# Autodesk Inventor assembly: Ensamblaje1
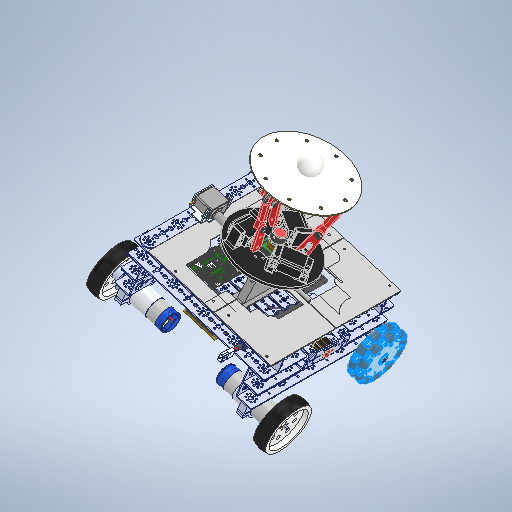
[picture p0: Inventor's stored thumbnail of the model, 512x512]
Saved by Autodesk Inventor 2025.4 (Build 294407000, 407)
## iProperties
Created: 2026-09-20
Part Number: Ensamblaje1
Document SubType Name: Assembly
Designer: usuario
Mass: 1778.88 g
Surface Area: 10785.4 cm^2
Volume: 1778.88 cm^3
Density: 1 g/cm^3
Author: usuario
## Documents named in this file (36)
- D:\Utec\Ciclo10\DSM\DSM_CAD_REPARADO\Ensamblaje1.iam
- D:\Utec\Ciclo10\DSM\DSM_CAD_REPARADO\Dependencias\EXT_003\Tetrix 4 inch Dual Omni Wheel(2).ipt
- D:\Utec\Ciclo10\DSM\DSM_CAD_REPARADO\Dependencias\EXT_003\Tetrix 4 inch Wheel.ipt
- D:\Utec\Ciclo10\DSM\DSM_CAD_REPARADO\Dependencias\EXT_003\Tetrix 32mm Channel.ipt
- D:\Utec\Ciclo10\DSM\DSM_CAD_REPARADO\Dependencias\EXT_003\Tetrix 96mm Channel.ipt
- D:\Utec\Ciclo10\DSM\DSM_CAD_REPARADO\Dependencias\EXT_003\Tetrix Motor Mount.ipt
- D:\Utec\Ciclo10\DSM\DSM_CAD_REPARADO\Dependencias\EXT_003\Tetrix TorqueNADO DC Motor(2).ipt
- D:\Utec\Ciclo10\DSM\DSM_CAD_REPARADO\Dependencias\EXT_003\Tetrix Flat Building Plate.ipt
- D:\Utec\Ciclo10\DSM\DSM_CAD_REPARADO\Dependencias\EXT_003\Tetrix 416mm Channel.ipt
- D:\Utec\Ciclo10\DSM\DSM_CAD_REPARADO\Dependencias\EXT_003\Tetrix Gear Hub Spacer.ipt
- D:\Utec\Ciclo10\DSM\DSM_CAD_REPARADO\Dependencias\EXT_003\Tetrix Flat 288mmx26mm.ipt
- D:\Utec\Ciclo10\DSM\DSM_CAD_REPARADO\Dependencias\EXT_003\Tetrix Battery Plate(2).ipt
- D:\Utec\Ciclo10\DSM\DSM_CAD_REPARADO\Dependencias\EXT_003\Motor Driver.ipt
- D:\Utec\Ciclo10\DSM\DSM_CAD_REPARADO\Dependencias\EXT_003\39057_txm-12v 3000mah battery pack assembly.ipt
- D:\Utec\Ciclo10\DSM\DSM_CAD_REPARADO\Dependencias\EXT_003\myRIO-1900-MJG_v1.ipt
- D:\Utec\Ciclo10\DSM\DSM_CAD_REPARADO\Dependencias\EXT_003\Raspberry Pi 4 Model B.ipt
- D:\Utec\Ciclo10\DSM\DSM_CAD_REPARADO\Dependencias\EXT_003\Tetrix Flat 160mm x26mm.ipt
- D:\Utec\Ciclo10\DSM\DSM_CAD_REPARADO\Dependencias\EXT_003\Tetrix StandOff Post 6-32x28mm.ipt
- D:\Utec\Ciclo10\DSM\DSM_CAD_REPARADO\Piezas\Base_inclinacion.ipt
- D:\Utec\Ciclo10\DSM\DSM_CAD_REPARADO\Piezas\adaptador_eje.ipt
- D:\Utec\Ciclo10\DSM\DSM_CAD_REPARADO\Piezas\Tetrix 6mm x 100mm Axle(2).ipt
- D:\Utec\Ciclo10\DSM\DSM_CAD_REPARADO\Piezas\Tetrix 485HB Standard Servo with Horn(2).ipt
- D:\Utec\Ciclo10\DSM\DSM_CAD_REPARADO\Piezas\Tetrix Axle Hub With Set Screw(2).ipt
- D:\Utec\Ciclo10\DSM\DSM_CAD_REPARADO\Piezas\Tetrix 96mm Channel(2).ipt
- D:\Utec\Ciclo10\DSM\DSM_CAD_REPARADO\Dependencias\EXT_002\ENSAMBLE_BALL_DSM.iam
- D:\Utec\Ciclo10\DSM\DSM_CAD_REPARADO\Piezas\39060_txm-standard servo bracket.ipt
- D:\Utec\Ciclo10\DSM\DSM_CAD_REPARADO\Piezas\Tetrix Flat 96mmx26mm.ipt
- D:\Utec\Ciclo10\DSM\DSM_CAD_REPARADO\Piezas\Tetrix L Bracket.ipt
- D:\Utec\Ciclo10\DSM\DSM_CAD_REPARADO\Piezas\39176_tetrixswitchmount.ipt
- D:\Utec\Ciclo10\DSM\DSM_CAD_REPARADO\Piezas\Apagador 2024.ipt
- D:\Utec\Ciclo10\DSM\DSM_CAD_REPARADO\Piezas\robot_v13.iam
- D:\Utec\Ciclo10\DSM\DSM_CAD_REPARADO\Piezas\CN6009.iam
- D:\Utec\Ciclo10\DSM\DSM_CAD_REPARADO\Piezas\Tetrix Bronze Bushing 6mm.ipt
- D:\Utec\Ciclo10\DSM\DSM_CAD_REPARADO\Piezas\Tetrix Axle Spacer 0.125.ipt
- D:\Utec\Ciclo10\DSM\DSM_CAD_REPARADO\Dependencias\EXT_001\40225_txp-6mm x 80mm axle.ipt
- D:\Utec\Ciclo10\DSM\DSM_CAD_REPARADO\Piezas\Tapa_2 - copia.ipt
## Components (64 placed, 35 different names)
1. Tetrix 4 inch Dual Omni Wheel(2):1 — Coincidencia:93, Coincidencia:270, Coincidencia:271, Coincidencia:277, Coincidencia:279
2. Tetrix 4 inch Dual Omni Wheel(2):2 — Coincidencia:262, Coincidencia:263, Coincidencia:268
3. Tetrix 4 inch Wheel:1 — Coincidencia:31, Coincidencia:32, Coincidencia:33, Coincidencia:35
4. Tetrix 4 inch Wheel:2 — Coincidencia:1, Coincidencia:2, Coincidencia:11
5. Tetrix 32mm Channel:2 — Coincidencia:12, Coincidencia:13, Coincidencia:93, Coincidencia:272, Coincidencia:273, Coincidencia:274, Coincidencia:275, Coincidencia:277, Coincidencia:283
6. Tetrix 32mm Channel:3 — Coincidencia:36, Coincidencia:37, Coincidencia:256, Coincidencia:257, Coincidencia:258, Coincidencia:259, Coincidencia:262, Coincidencia:281
7. Tetrix 96mm Channel:3 — Coincidencia:46, Coincidencia:47, Coincidencia:48
8. Tetrix Motor Mount:1 — Coincidencia:7, Coincidencia:8, Coincidencia:9, Coincidencia:10, Coincidencia:11
9. Tetrix Motor Mount:2 — Coincidencia:27, Coincidencia:28, Coincidencia:29, Coincidencia:30, Coincidencia:35
10. Tetrix TorqueNADO DC Motor(2):1 — Coincidencia:3, Coincidencia:4, Coincidencia:10
11. Tetrix TorqueNADO DC Motor(2):2 — Coincidencia:30, Coincidencia:31, Coincidencia:34
12. Tetrix Flat Building Plate:1 — Coincidencia:89, Coincidencia:90, Coincidencia:91, Coincidencia:142, Coincidencia:215, Coincidencia:216, Coincidencia:217, Coincidencia:240, Coincidencia:241, Coincidencia:242
13. Tetrix Flat Building Plate:2 — Coincidencia:86, Coincidencia:87, Coincidencia:88, Coincidencia:196, Coincidencia:218, Coincidencia:219, Coincidencia:220, Coincidencia:236, Coincidencia:237, Coincidencia:238, Coincidencia:239, Coincidencia:246, Coincidencia:247, Coincidencia:248, Coincidencia:249, Coincidencia:250, Coincidencia:251, Coincidencia:252
14. Tetrix 416mm Channel:1 — Coincidencia:7, Coincidencia:8, Coincidencia:9, Coincidencia:12, Coincidencia:13, Coincidencia:46, Coincidencia:47, Coincidencia:48, Coincidencia:55, Coincidencia:56, Coincidencia:57, Coincidencia:78, Coincidencia:79, Coincidencia:80, Coincidencia:84, Coincidencia:85
15. Tetrix Gear Hub Spacer:2 — Coincidencia:1, Coincidencia:2, Coincidencia:3, Coincidencia:4
16. Tetrix Gear Hub Spacer:4 — Coincidencia:32, Coincidencia:33, Coincidencia:34
17. Tetrix 416mm Channel:2 — Coincidencia:27, Coincidencia:28, Coincidencia:29, Coincidencia:36, Coincidencia:37, Coincidencia:49, Coincidencia:50, Coincidencia:51, Coincidencia:52, Coincidencia:53, Coincidencia:54, Coincidencia:77, Coincidencia:81, Coincidencia:82, Coincidencia:83, Coincidencia:226, Coincidencia:227
18. Tetrix 416mm Channel:3 — Coincidencia:168, Coincidencia:169, Coincidencia:170, Coincidencia:172, Coincidencia:209, Coincidencia:294, Coincidencia:295
19. Tetrix 96mm Channel:4 — Coincidencia:49, Coincidencia:50, Coincidencia:51, Coincidencia:105, Coincidencia:107, Coincidencia:168, Coincidencia:169, Coincidencia:170
20. Tetrix 96mm Channel:5 — Coincidencia:52, Coincidencia:53, Coincidencia:54, Coincidencia:91
21. Tetrix 96mm Channel:6 — Coincidencia:55, Coincidencia:56, Coincidencia:57, Coincidencia:88, Coincidencia:165, Coincidencia:166, Coincidencia:167
22. Tetrix 416mm Channel:4 — Coincidencia:165, Coincidencia:166, Coincidencia:167, Coincidencia:171, Coincidencia:173
23. Tetrix Flat 288mmx26mm:1 — Coincidencia:83, Coincidencia:84, Coincidencia:85, Coincidencia:116, Coincidencia:117, Coincidencia:118, Coincidencia:119, Coincidencia:162
24. Tetrix Flat 288mmx26mm:2 — Coincidencia:80, Coincidencia:81, Coincidencia:82, Coincidencia:86, Coincidencia:89, Coincidencia:163, Coincidencia:223, Coincidencia:224, Coincidencia:225
25. Tetrix Flat 288mmx26mm:3 — Coincidencia:77, Coincidencia:78, Coincidencia:79, Coincidencia:87, Coincidencia:90, Coincidencia:197, Coincidencia:228, Coincidencia:229, Coincidencia:245
26. Tetrix Battery Plate(2):2 — Coincidencia:105, Coincidencia:107, Coincidencia:149, Coincidencia:209
27. Motor Driver:1 — Coincidencia:221, Coincidencia:222, Coincidencia:236
28. 39057_txm-12v 3000mah battery pack assembly:1 — Coincidencia:142, Coincidencia:149
29. myRIO-1900-MJG_v1:1 — Coincidencia:162, Coincidencia:163, Coincidencia:164
30. Raspberry Pi 4 Model B:1 — Coincidencia:247, Coincidencia:248, Coincidencia:249
31. Tetrix Flat 160mm x26mm:2 — Coincidencia:120, Coincidencia:121, Coincidencia:122
32. Tetrix StandOff Post 6-32x28mm:1 — Coincidencia:116, Coincidencia:117, Coincidencia:122
33. Tetrix StandOff Post 6-32x28mm:3 — Coincidencia:118, Coincidencia:119, Coincidencia:120, Coincidencia:121, Coincidencia:164
34. Tetrix Flat 288mmx26mm:4 — Coincidencia:171, Coincidencia:172, Coincidencia:173, Coincidencia:200, Coincidencia:201, Coincidencia:253
35. Base_inclinacion:1 — Coincidencia:175, Coincidencia:176, Coincidencia:177, Coincidencia:178, Coincidencia:196, Coincidencia:197, Coincidencia:223
36. adaptador_eje:1 — Coincidencia:185, Coincidencia:186, Coincidencia:198
37. Tetrix 6mm x 100mm Axle(2):1 — Coincidencia:198, Coincidencia:199
38. Tetrix 485HB Standard Servo with Horn(2):1 — Coincidencia:185, Coincidencia:186, Coincidencia:188, Coincidencia:189, Coincidencia:190, Coincidencia:199
39. Tetrix Axle Hub With Set Screw(2):1 — Coincidencia:177, Coincidencia:178
40. Tetrix Axle Hub With Set Screw(2):2 — Coincidencia:175, Coincidencia:176, Coincidencia:194, Coincidencia:195
41. Tetrix 96mm Channel(2):1 — Coincidencia:194, Coincidencia:195, Coincidencia:290, Coincidencia:291, Coincidencia:292, Coincidencia:293
42. ENSAMBLE_BALL_DSM:1 [sub-assembly] — Coincidencia:290, Coincidencia:291, Coincidencia:292, Coincidencia:293
43. 39060_txm-standard servo bracket:1 — Coincidencia:188, Coincidencia:189, Coincidencia:190, Coincidencia:200, Coincidencia:201, Coincidencia:253
44. Tetrix Flat 96mmx26mm:3 — Coincidencia:215, Coincidencia:216, Coincidencia:217, Coincidencia:221, Coincidencia:222
45. Tetrix Flat 96mmx26mm:4 — Coincidencia:218, Coincidencia:219, Coincidencia:220
46. Tetrix L Bracket:1 — Coincidencia:224, Coincidencia:225, Coincidencia:226, Coincidencia:234, Coincidencia:235
47. Tetrix L Bracket:2 — Coincidencia:227, Coincidencia:228, Coincidencia:229, Coincidencia:233
48. 39176_tetrixswitchmount:1 — Coincidencia:230, Coincidencia:231, Coincidencia:232, Coincidencia:233, Coincidencia:234, Coincidencia:235
49. Apagador 2024:1 — Coincidencia:230, Coincidencia:231, Coincidencia:232
50. robot_v13:1 [sub-assembly] — Coincidencia:244, Coincidencia:245, Coincidencia:246
51. Tetrix Flat 96mmx26mm:5 — Coincidencia:237, Coincidencia:238, Coincidencia:239, Coincidencia:244
52. Tetrix Flat 96mmx26mm:6 — Coincidencia:240, Coincidencia:241, Coincidencia:242
53. CN6009:1 [sub-assembly] — Coincidencia:250, Coincidencia:251, Coincidencia:252
54. Tetrix Bronze Bushing 6mm:4 — Coincidencia:256, Coincidencia:257, Coincidencia:269
55. Tetrix Bronze Bushing 6mm:5 — Coincidencia:258, Coincidencia:259
56. Tetrix Axle Spacer 0.125:1 — Coincidencia:263, Coincidencia:266, Coincidencia:267
57. 40225_txp-6mm x 80mm axle:1 — Coincidencia:266, Coincidencia:267, Coincidencia:268, Coincidencia:269, Coincidencia:280
58. 40225_txp-6mm x 80mm axle:2 — Coincidencia:270, Coincidencia:271, Coincidencia:276, Coincidencia:278, Coincidencia:282
59. Tetrix Bronze Bushing 6mm:6 — Coincidencia:272, Coincidencia:273, Coincidencia:276
60. Tetrix Bronze Bushing 6mm:7 — Coincidencia:274, Coincidencia:275
61. Tetrix Axle Spacer 0.125:3 — Coincidencia:278, Coincidencia:279
62. Tetrix Axle Spacer 0.125:4 — Coincidencia:280, Coincidencia:281
63. Tetrix Axle Spacer 0.125:5 — Coincidencia:282, Coincidencia:283
64. Tapa_2 - copia:1 — Coincidencia:294, Coincidencia:295
## Relationships (159: Mate 159)
- Coincidencia:1 [Mate]: Tetrix 4 inch Wheel:2 ↔ Tetrix Gear Hub Spacer:2
- Coincidencia:2 [Mate]: Tetrix 4 inch Wheel:2 ↔ Tetrix Gear Hub Spacer:2
- Coincidencia:3 [Mate]: Tetrix TorqueNADO DC Motor(2):1 ↔ Tetrix Gear Hub Spacer:2
- Coincidencia:4 [Mate]: Tetrix TorqueNADO DC Motor(2):1 ↔ Tetrix Gear Hub Spacer:2
- Coincidencia:7 [Mate]: Tetrix Motor Mount:1 ↔ Tetrix 416mm Channel:1
- Coincidencia:8 [Mate]: Tetrix Motor Mount:1 ↔ Tetrix 416mm Channel:1
- Coincidencia:9 [Mate]: Tetrix Motor Mount:1 ↔ Tetrix 416mm Channel:1
- Coincidencia:10 [Mate]: Tetrix Motor Mount:1 ↔ Tetrix TorqueNADO DC Motor(2):1
- Coincidencia:11 [Mate] (35 mm): Tetrix 4 inch Wheel:2 ↔ Tetrix Motor Mount:1
- Coincidencia:12 [Mate]: Tetrix 32mm Channel:2 ↔ Tetrix 416mm Channel:1
- Coincidencia:13 [Mate]: Tetrix 32mm Channel:2 ↔ Tetrix 416mm Channel:1
- Coincidencia:27 [Mate]: Tetrix Motor Mount:2 ↔ Tetrix 416mm Channel:2
- Coincidencia:28 [Mate]: Tetrix Motor Mount:2 ↔ Tetrix 416mm Channel:2
- Coincidencia:29 [Mate]: Tetrix Motor Mount:2 ↔ Tetrix 416mm Channel:2
- Coincidencia:30 [Mate]: Tetrix Motor Mount:2 ↔ Tetrix TorqueNADO DC Motor(2):2
- Coincidencia:31 [Mate]: Tetrix 4 inch Wheel:1 ↔ Tetrix TorqueNADO DC Motor(2):2
- Coincidencia:32 [Mate]: Tetrix 4 inch Wheel:1 ↔ Tetrix Gear Hub Spacer:4
- Coincidencia:33 [Mate]: Tetrix 4 inch Wheel:1 ↔ Tetrix Gear Hub Spacer:4
- Coincidencia:34 [Mate]: Tetrix TorqueNADO DC Motor(2):2 ↔ Tetrix Gear Hub Spacer:4
- Coincidencia:35 [Mate] (35 mm): Tetrix 4 inch Wheel:1 ↔ Tetrix Motor Mount:2
- Coincidencia:36 [Mate]: Tetrix 32mm Channel:3 ↔ Tetrix 416mm Channel:2
- Coincidencia:37 [Mate]: Tetrix 32mm Channel:3 ↔ Tetrix 416mm Channel:2
- Coincidencia:46 [Mate]: Tetrix 96mm Channel:3 ↔ Tetrix 416mm Channel:1
- Coincidencia:47 [Mate]: Tetrix 96mm Channel:3 ↔ Tetrix 416mm Channel:1
- Coincidencia:48 [Mate]: Tetrix 96mm Channel:3 ↔ Tetrix 416mm Channel:1
- Coincidencia:49 [Mate]: Tetrix 416mm Channel:2 ↔ Tetrix 96mm Channel:4
- Coincidencia:50 [Mate]: Tetrix 416mm Channel:2 ↔ Tetrix 96mm Channel:4
- Coincidencia:51 [Mate]: Tetrix 416mm Channel:2 ↔ Tetrix 96mm Channel:4
- Coincidencia:52 [Mate]: Tetrix 416mm Channel:2 ↔ Tetrix 96mm Channel:5
- Coincidencia:53 [Mate]: Tetrix 416mm Channel:2 ↔ Tetrix 96mm Channel:5
- Coincidencia:54 [Mate]: Tetrix 416mm Channel:2 ↔ Tetrix 96mm Channel:5
- Coincidencia:55 [Mate]: Tetrix 416mm Channel:1 ↔ Tetrix 96mm Channel:6
- Coincidencia:56 [Mate]: Tetrix 416mm Channel:1 ↔ Tetrix 96mm Channel:6
- Coincidencia:57 [Mate]: Tetrix 416mm Channel:1 ↔ Tetrix 96mm Channel:6
- Coincidencia:77 [Mate]: Tetrix 416mm Channel:2 ↔ Tetrix Flat 288mmx26mm:3
- Coincidencia:78 [Mate]: Tetrix 416mm Channel:1 ↔ Tetrix Flat 288mmx26mm:3
- Coincidencia:79 [Mate]: Tetrix 416mm Channel:1 ↔ Tetrix Flat 288mmx26mm:3
- Coincidencia:80 [Mate]: Tetrix 416mm Channel:1 ↔ Tetrix Flat 288mmx26mm:2
- Coincidencia:81 [Mate]: Tetrix 416mm Channel:2 ↔ Tetrix Flat 288mmx26mm:2
- Coincidencia:82 [Mate]: Tetrix 416mm Channel:2 ↔ Tetrix Flat 288mmx26mm:2
- Coincidencia:83 [Mate]: Tetrix 416mm Channel:2 ↔ Tetrix Flat 288mmx26mm:1
- Coincidencia:84 [Mate]: Tetrix 416mm Channel:1 ↔ Tetrix Flat 288mmx26mm:1
- Coincidencia:85 [Mate]: Tetrix 416mm Channel:1 ↔ Tetrix Flat 288mmx26mm:1
- Coincidencia:86 [Mate]: Tetrix Flat Building Plate:2 ↔ Tetrix Flat 288mmx26mm:2
- Coincidencia:87 [Mate]: Tetrix Flat Building Plate:2 ↔ Tetrix Flat 288mmx26mm:3
- Coincidencia:88 [Mate]: Tetrix Flat Building Plate:2 ↔ Tetrix 96mm Channel:6
- Coincidencia:89 [Mate]: Tetrix Flat Building Plate:1 ↔ Tetrix Flat 288mmx26mm:2
- Coincidencia:90 [Mate]: Tetrix Flat Building Plate:1 ↔ Tetrix Flat 288mmx26mm:3
- Coincidencia:91 [Mate]: Tetrix Flat Building Plate:1 ↔ Tetrix 96mm Channel:5
- Coincidencia:93 [Mate]: Tetrix 4 inch Dual Omni Wheel(2):1 ↔ Tetrix 32mm Channel:2
- Coincidencia:105 [Mate]: Tetrix 96mm Channel:4 ↔ Tetrix Battery Plate(2):2
- Coincidencia:107 [Mate]: Tetrix 96mm Channel:4 ↔ Tetrix Battery Plate(2):2
- Coincidencia:116 [Mate]: Tetrix Flat 288mmx26mm:1 ↔ Tetrix StandOff Post 6-32x28mm:1
- Coincidencia:117 [Mate]: Tetrix Flat 288mmx26mm:1 ↔ Tetrix StandOff Post 6-32x28mm:1
- Coincidencia:118 [Mate]: Tetrix Flat 288mmx26mm:1 ↔ Tetrix StandOff Post 6-32x28mm:3
- Coincidencia:119 [Mate]: Tetrix Flat 288mmx26mm:1 ↔ Tetrix StandOff Post 6-32x28mm:3
- Coincidencia:120 [Mate]: Tetrix Flat 160mm x26mm:2 ↔ Tetrix StandOff Post 6-32x28mm:3
- Coincidencia:121 [Mate]: Tetrix Flat 160mm x26mm:2 ↔ Tetrix StandOff Post 6-32x28mm:3
- Coincidencia:122 [Mate]: Tetrix Flat 160mm x26mm:2 ↔ Tetrix StandOff Post 6-32x28mm:1
- Coincidencia:142 [Mate]: Tetrix Flat Building Plate:1 ↔ 39057_txm-12v 3000mah battery pack assembly:1
- Coincidencia:149 [Mate]: Tetrix Battery Plate(2):2 ↔ 39057_txm-12v 3000mah battery pack assembly:1
- Coincidencia:162 [Mate]: Tetrix Flat 288mmx26mm:1 ↔ myRIO-1900-MJG_v1:1
- Coincidencia:163 [Mate]: Tetrix Flat 288mmx26mm:2 ↔ myRIO-1900-MJG_v1:1
- Coincidencia:164 [Mate]: myRIO-1900-MJG_v1:1 ↔ Tetrix StandOff Post 6-32x28mm:3
- Coincidencia:165 [Mate]: Tetrix 96mm Channel:6 ↔ Tetrix 416mm Channel:4
- Coincidencia:166 [Mate]: Tetrix 96mm Channel:6 ↔ Tetrix 416mm Channel:4
- Coincidencia:167 [Mate]: Tetrix 96mm Channel:6 ↔ Tetrix 416mm Channel:4
- Coincidencia:168 [Mate]: Tetrix 416mm Channel:3 ↔ Tetrix 96mm Channel:4
- Coincidencia:169 [Mate]: Tetrix 416mm Channel:3 ↔ Tetrix 96mm Channel:4
- Coincidencia:170 [Mate]: Tetrix 416mm Channel:3 ↔ Tetrix 96mm Channel:4
- Coincidencia:171 [Mate]: Tetrix 416mm Channel:4 ↔ Tetrix Flat 288mmx26mm:4
- Coincidencia:172 [Mate]: Tetrix 416mm Channel:3 ↔ Tetrix Flat 288mmx26mm:4
- Coincidencia:173 [Mate]: Tetrix 416mm Channel:4 ↔ Tetrix Flat 288mmx26mm:4
- Coincidencia:175 [Mate]: Base_inclinacion:1 ↔ Tetrix Axle Hub With Set Screw(2):2
- Coincidencia:176 [Mate]: Base_inclinacion:1 ↔ Tetrix Axle Hub With Set Screw(2):2
- Coincidencia:177 [Mate]: Base_inclinacion:1 ↔ Tetrix Axle Hub With Set Screw(2):1
- Coincidencia:178 [Mate]: Base_inclinacion:1 ↔ Tetrix Axle Hub With Set Screw(2):1
- Coincidencia:185 [Mate]: adaptador_eje:1 ↔ Tetrix 485HB Standard Servo with Horn(2):1
- Coincidencia:186 [Mate]: adaptador_eje:1 ↔ Tetrix 485HB Standard Servo with Horn(2):1
- Coincidencia:188 [Mate]: Tetrix 485HB Standard Servo with Horn(2):1 ↔ 39060_txm-standard servo bracket:1
- Coincidencia:189 [Mate]: Tetrix 485HB Standard Servo with Horn(2):1 ↔ 39060_txm-standard servo bracket:1
- Coincidencia:190 [Mate]: Tetrix 485HB Standard Servo with Horn(2):1 ↔ 39060_txm-standard servo bracket:1
- Coincidencia:194 [Mate]: Tetrix Axle Hub With Set Screw(2):2 ↔ Tetrix 96mm Channel(2):1
- Coincidencia:195 [Mate]: Tetrix Axle Hub With Set Screw(2):2 ↔ Tetrix 96mm Channel(2):1
- Coincidencia:196 [Mate] (34 mm): Tetrix Flat Building Plate:2 ↔ Base_inclinacion:1
- Coincidencia:197 [Mate]: Tetrix Flat 288mmx26mm:3 ↔ Base_inclinacion:1
- Coincidencia:198 [Mate]: adaptador_eje:1 ↔ Tetrix 6mm x 100mm Axle(2):1
- Coincidencia:199 [Mate]: Tetrix 6mm x 100mm Axle(2):1 ↔ Tetrix 485HB Standard Servo with Horn(2):1
- Coincidencia:200 [Mate]: Tetrix Flat 288mmx26mm:4 ↔ 39060_txm-standard servo bracket:1
- Coincidencia:201 [Mate]: Tetrix Flat 288mmx26mm:4 ↔ 39060_txm-standard servo bracket:1
- Coincidencia:209 [Mate]: Tetrix 416mm Channel:3 ↔ Tetrix Battery Plate(2):2
- Coincidencia:215 [Mate]: Tetrix Flat Building Plate:1 ↔ Tetrix Flat 96mmx26mm:3
- Coincidencia:216 [Mate]: Tetrix Flat Building Plate:1 ↔ Tetrix Flat 96mmx26mm:3
- Coincidencia:217 [Mate]: Tetrix Flat Building Plate:1 ↔ Tetrix Flat 96mmx26mm:3
- Coincidencia:218 [Mate]: Tetrix Flat Building Plate:2 ↔ Tetrix Flat 96mmx26mm:4
- Coincidencia:219 [Mate]: Tetrix Flat Building Plate:2 ↔ Tetrix Flat 96mmx26mm:4
- Coincidencia:220 [Mate]: Tetrix Flat Building Plate:2 ↔ Tetrix Flat 96mmx26mm:4
- Coincidencia:221 [Mate]: Motor Driver:1 ↔ Tetrix Flat 96mmx26mm:3
- Coincidencia:222 [Mate] (6 mm): Motor Driver:1 ↔ Tetrix Flat 96mmx26mm:3
- Coincidencia:223 [Mate]: Tetrix Flat 288mmx26mm:2 ↔ Base_inclinacion:1
- Coincidencia:224 [Mate]: Tetrix Flat 288mmx26mm:2 ↔ Tetrix L Bracket:1
- Coincidencia:225 [Mate]: Tetrix Flat 288mmx26mm:2 ↔ Tetrix L Bracket:1
- Coincidencia:226 [Mate]: Tetrix 416mm Channel:2 ↔ Tetrix L Bracket:1
- Coincidencia:227 [Mate]: Tetrix 416mm Channel:2 ↔ Tetrix L Bracket:2
- Coincidencia:228 [Mate]: Tetrix Flat 288mmx26mm:3 ↔ Tetrix L Bracket:2
- Coincidencia:229 [Mate]: Tetrix Flat 288mmx26mm:3 ↔ Tetrix L Bracket:2
- Coincidencia:230 [Mate]: 39176_tetrixswitchmount:1 ↔ Apagador 2024:1
- Coincidencia:231 [Mate] (2.8 mm): 39176_tetrixswitchmount:1 ↔ Apagador 2024:1
- Coincidencia:232 [Mate] (1.2 mm): 39176_tetrixswitchmount:1 ↔ Apagador 2024:1
- Coincidencia:233 [Mate]: Tetrix L Bracket:2 ↔ 39176_tetrixswitchmount:1
- Coincidencia:234 [Mate]: Tetrix L Bracket:1 ↔ 39176_tetrixswitchmount:1
- Coincidencia:235 [Mate]: Tetrix L Bracket:1 ↔ 39176_tetrixswitchmount:1
- Coincidencia:236 [Mate] (6 mm): Tetrix Flat Building Plate:2 ↔ Motor Driver:1
- Coincidencia:237 [Mate]: Tetrix Flat Building Plate:2 ↔ Tetrix Flat 96mmx26mm:5
- Coincidencia:238 [Mate]: Tetrix Flat Building Plate:2 ↔ Tetrix Flat 96mmx26mm:5
- Coincidencia:239 [Mate]: Tetrix Flat Building Plate:2 ↔ Tetrix Flat 96mmx26mm:5
- Coincidencia:240 [Mate]: Tetrix Flat Building Plate:1 ↔ Tetrix Flat 96mmx26mm:6
- Coincidencia:241 [Mate]: Tetrix Flat Building Plate:1 ↔ Tetrix Flat 96mmx26mm:6
- Coincidencia:242 [Mate]: Tetrix Flat Building Plate:1 ↔ Tetrix Flat 96mmx26mm:6
- Coincidencia:244 [Mate]: robot_v13:1 ↔ Tetrix Flat 96mmx26mm:5
- Coincidencia:245 [Mate] (20 mm): Tetrix Flat 288mmx26mm:3 ↔ robot_v13:1
- Coincidencia:246 [Mate] (15 mm): Tetrix Flat Building Plate:2 ↔ robot_v13:1
- Coincidencia:247 [Mate]: Tetrix Flat Building Plate:2 ↔ Raspberry Pi 4 Model B:1
- Coincidencia:248 [Mate] (10 mm): Tetrix Flat Building Plate:2 ↔ Raspberry Pi 4 Model B:1
- Coincidencia:249 [Mate] (60 mm): Tetrix Flat Building Plate:2 ↔ Raspberry Pi 4 Model B:1
- Coincidencia:250 [Mate]: Tetrix Flat Building Plate:2 ↔ CN6009:1
- Coincidencia:251 [Mate] (15 mm): Tetrix Flat Building Plate:2 ↔ CN6009:1
- Coincidencia:252 [Mate] (12 mm): Tetrix Flat Building Plate:2 ↔ CN6009:1
- Coincidencia:253 [Mate]: Tetrix Flat 288mmx26mm:4 ↔ 39060_txm-standard servo bracket:1
- Coincidencia:256 [Mate]: Tetrix 32mm Channel:3 ↔ Tetrix Bronze Bushing 6mm:4
- Coincidencia:257 [Mate]: Tetrix 32mm Channel:3 ↔ Tetrix Bronze Bushing 6mm:4
- Coincidencia:258 [Mate]: Tetrix 32mm Channel:3 ↔ Tetrix Bronze Bushing 6mm:5
- Coincidencia:259 [Mate]: Tetrix 32mm Channel:3 ↔ Tetrix Bronze Bushing 6mm:5
- Coincidencia:262 [Mate]: Tetrix 4 inch Dual Omni Wheel(2):2 ↔ Tetrix 32mm Channel:3
- Coincidencia:263 [Mate]: Tetrix 4 inch Dual Omni Wheel(2):2 ↔ Tetrix Axle Spacer 0.125:1
- Coincidencia:266 [Mate]: Tetrix Axle Spacer 0.125:1 ↔ 40225_txp-6mm x 80mm axle:1
- Coincidencia:267 [Mate]: Tetrix Axle Spacer 0.125:1 ↔ 40225_txp-6mm x 80mm axle:1
- Coincidencia:268 [Mate]: Tetrix 4 inch Dual Omni Wheel(2):2 ↔ 40225_txp-6mm x 80mm axle:1
- Coincidencia:269 [Mate]: Tetrix Bronze Bushing 6mm:4 ↔ 40225_txp-6mm x 80mm axle:1
- Coincidencia:270 [Mate]: Tetrix 4 inch Dual Omni Wheel(2):1 ↔ 40225_txp-6mm x 80mm axle:2
- Coincidencia:271 [Mate]: Tetrix 4 inch Dual Omni Wheel(2):1 ↔ 40225_txp-6mm x 80mm axle:2
- Coincidencia:272 [Mate]: Tetrix 32mm Channel:2 ↔ Tetrix Bronze Bushing 6mm:6
- Coincidencia:273 [Mate]: Tetrix 32mm Channel:2 ↔ Tetrix Bronze Bushing 6mm:6
- Coincidencia:274 [Mate]: Tetrix 32mm Channel:2 ↔ Tetrix Bronze Bushing 6mm:7
- Coincidencia:275 [Mate]: Tetrix 32mm Channel:2 ↔ Tetrix Bronze Bushing 6mm:7
- Coincidencia:276 [Mate]: 40225_txp-6mm x 80mm axle:2 ↔ Tetrix Bronze Bushing 6mm:6
- Coincidencia:277 [Mate]: Tetrix 4 inch Dual Omni Wheel(2):1 ↔ Tetrix 32mm Channel:2
- Coincidencia:278 [Mate]: 40225_txp-6mm x 80mm axle:2 ↔ Tetrix Axle Spacer 0.125:3
- Coincidencia:279 [Mate]: Tetrix 4 inch Dual Omni Wheel(2):1 ↔ Tetrix Axle Spacer 0.125:3
- Coincidencia:280 [Mate]: 40225_txp-6mm x 80mm axle:1 ↔ Tetrix Axle Spacer 0.125:4
- Coincidencia:281 [Mate]: Tetrix 32mm Channel:3 ↔ Tetrix Axle Spacer 0.125:4
- Coincidencia:282 [Mate]: 40225_txp-6mm x 80mm axle:2 ↔ Tetrix Axle Spacer 0.125:5
- Coincidencia:283 [Mate]: Tetrix 32mm Channel:2 ↔ Tetrix Axle Spacer 0.125:5
- Coincidencia:290 [Mate]: Tetrix 96mm Channel(2):1 ↔ ENSAMBLE_BALL_DSM:1
- Coincidencia:291 [Mate]: Tetrix 96mm Channel(2):1 ↔ ENSAMBLE_BALL_DSM:1
- Coincidencia:292 [Mate]: Tetrix 96mm Channel(2):1 ↔ ENSAMBLE_BALL_DSM:1
- Coincidencia:293 [Mate]: Tetrix 96mm Channel(2):1 ↔ ENSAMBLE_BALL_DSM:1
- Coincidencia:294 [Mate]: Tetrix 416mm Channel:3 ↔ Tapa_2 - copia:1
- Coincidencia:295 [Mate]: Tetrix 416mm Channel:3 ↔ Tapa_2 - copia:1
